# Autodesk Inventor assembly: decoder
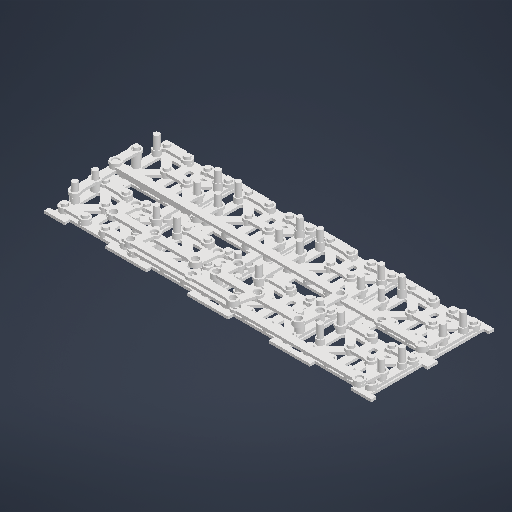
[picture p0: Inventor's stored thumbnail of the model, 512x512]
Saved by Autodesk Inventor 2025.4 (Build 294407000, 407)
## iProperties
Created: 2026-09-15
Part Number: decoder
Document SubType Name: Assembly
Designer: User
Author: User
## Documents named in this file (18)
- G:\projects\primary\mechanical-computer\mechanics\gates\decoder.iam
- G:\projects\primary\mechanical-computer\mechanics\lock\lock.iam
- G:\projects\primary\mechanical-computer\mechanics\links\link.ipt
- G:\projects\primary\mechanical-computer\mechanics\links\link\link-8.ipt
- G:\projects\primary\mechanical-computer\mechanics\links\link-1-turn-rigid\link-1-turn-rigid-8(_AS)4w-8l.ipt
- G:\projects\primary\mechanical-computer\mechanics\links\link-1-turn-rigid.ipt
- G:\projects\primary\mechanical-computer\mechanics\links\link\link-16.ipt
- G:\projects\primary\mechanical-computer\mechanics\links\link-split\link-split-16ab.ipt
- G:\projects\primary\mechanical-computer\mechanics\links\link-split.ipt
- G:\projects\primary\mechanical-computer\mechanics\links\link-split\link-split-8(_AS)5a-8(_AS)6b.ipt
- G:\projects\primary\mechanical-computer\mechanics\links\leveller.ipt
- G:\projects\primary\mechanical-computer\mechanics\links\leveller\leveller-2.ipt
- G:\projects\primary\mechanical-computer\mechanics\links\link-split\link-split-8(_AS)2ab.ipt
- G:\projects\primary\mechanical-computer\mechanics\links\link-split\link-split-8(_AS)3a-8(_AS)2b.ipt
- G:\projects\primary\mechanical-computer\mechanics\links\link\link-8-1pin.ipt
- G:\projects\primary\mechanical-computer\mechanics\links\link-1-turn-rigid\link-1-turn-rigid-11(_AS)8w-8l.ipt
- G:\projects\primary\mechanical-computer\mechanics\links\leveller\leveller-3.ipt
- G:\projects\primary\mechanical-computer\mechanics\links\leveller\leveller-1.ipt
## Components (40 placed, 14 different names)
1. link-1-turn-rigid-8(_AS)4w-8l:1 — Cylindrical:9, Cylindrical:10, Cylindrical:52, Mate:50
2. link-split-16ab:1 — Mate:20, Cylindrical:48, Cylindrical:50
3. link-1-turn-rigid-11(_AS)8w-8l:2 — Cylindrical:29, Cylindrical:30, Mate:49, Cylindrical:62
4. link-split-8(_AS)5a-8(_AS)6b:3 — Mate:25, Cylindrical:46, Cylindrical:47
5. leveller-1:6 — Mate:52, Cylindrical:58
6. leveller-1:7 — Mate:53, Cylindrical:59
7. leveller-1:8 — Mate:54, Cylindrical:60
8. leveller-1:9 — Mate:55, Cylindrical:61
9. lock:1 [sub-assembly] — Mate:1, Flush:1, Flush:2, Mate:3, Flush:5, Flush:6, Cylindrical:9, Cylindrical:10, Cylindrical:13, Mate:14, Mate:27, Mate:28, Mate:29, Mate:30, Cylindrical:53
10. lock:2 [sub-assembly] — Mate:1, Flush:1, Flush:2, Mate:7, Flush:13, Flush:14, Cylindrical:15, Mate:15, Cylindrical:32, Mate:26, Cylindrical:54
11. lock:3 [sub-assembly] — Mate:3, Flush:5, Flush:6, Cylindrical:14, Mate:36, Mate:37, Mate:55, Cylindrical:61, Cylindrical:63
12. lock:4 [sub-assembly] — Cylindrical:12, Mate:13, Cylindrical:16, Mate:54, Cylindrical:60
13. lock:5 [sub-assembly] — Mate:7, Flush:13, Flush:14, Cylindrical:17, Mate:16, Cylindrical:29, Cylindrical:30, Mate:32, Mate:33, Mate:34, Mate:35, Cylindrical:55
14. lock:6 [sub-assembly] — Cylindrical:19, Mate:17, Cylindrical:33, Mate:24, Cylindrical:56
15. lock:7 [sub-assembly] — Cylindrical:18, Mate:18, Cylindrical:51, Mate:53, Cylindrical:59
16. lock:8 [sub-assembly] — Cylindrical:20, Mate:19, Cylindrical:49, Mate:52, Cylindrical:58
17. leveller:1 — Mate:27, Mate:28
18. leveller:2 — Mate:29, Mate:30, Mate:50
19. leveller-2:3 — Mate:32, Mate:33
20. leveller-2:4 — Mate:34, Mate:35, Mate:49
21. leveller-3:5 — Mate:36, Mate:37, Mate:56
22. link-8-1pin:5 — Cylindrical:12, Mate:13, Cylindrical:52
23. link-8-1pin:12 — Mate:18, Cylindrical:50, Cylindrical:51
24. link-8-1pin:13 — Mate:19, Mate:20, Cylindrical:48, Cylindrical:49
25. link-8-1pin:14 — Mate:56, Cylindrical:62, Cylindrical:63
26. link-8-1pin:15 — Cylindrical:32, Mate:26, Cylindrical:47
27. link-8-1pin:16 — Cylindrical:33, Mate:24, Mate:25, Cylindrical:46
28. link-16:6 — Cylindrical:13, Cylindrical:14, Mate:14
29. link-16:7 — Cylindrical:15, Cylindrical:16, Mate:15
30. link-16:8 — Cylindrical:17, Cylindrical:18, Mate:16
31. link-16:9 — Cylindrical:19, Cylindrical:20, Mate:17
32. link-split-8(_AS)2ab:4 — Cylindrical:36, Cylindrical:38, Mate:38, Mate:39, Cylindrical:41, Mate:46
33. link-split-8(_AS)2ab:5 — Cylindrical:37, Cylindrical:39, Mate:40, Mate:41, Cylindrical:40, Mate:47
34. link-split-8(_AS)3a-8(_AS)2b:6 — Cylindrical:42, Cylindrical:43, Mate:44, Mate:45
35. link-8:21 — Cylindrical:41, Cylindrical:42, Mate:44, Mate:46
36. link-8:22 — Cylindrical:40, Cylindrical:43, Mate:45, Mate:47
37. link-8:18 — Cylindrical:36, Mate:39, Cylindrical:54
38. link-8:17 — Cylindrical:38, Mate:38, Cylindrical:53
39. link-8:19 — Cylindrical:39, Mate:40, Cylindrical:55
40. link-8:20 — Cylindrical:37, Mate:41, Cylindrical:56
## Relationships (97: Mate 43, CylindricalJoint 40, Flush 14)
- Mate:1: lock:1 ↔ lock:2
- Flush:1: lock:1 ↔ lock:2
- Flush:2: lock:1 ↔ lock:2
- [Mate]: lock:3 ↔ lock:4
- [Flush]: lock:3 ↔ lock:4
- [Flush]: lock:3 ↔ lock:4
- Mate:3: lock:1 ↔ lock:3
- Flush:5: lock:1 ↔ lock:3
- Flush:6: lock:1 ↔ lock:3
- [Mate]: lock:5 ↔ lock:6
- [Flush]: lock:5 ↔ lock:6
- [Flush]: lock:5 ↔ lock:6
- [Mate]: lock:7 ↔ lock:8
- [Flush]: lock:7 ↔ lock:8
- [Flush]: lock:7 ↔ lock:8
- [Mate]: lock:5 ↔ lock:7
- [Flush]: lock:5 ↔ lock:7
- [Flush]: lock:5 ↔ lock:7
- Mate:7: lock:2 ↔ lock:5
- Flush:13: lock:2 ↔ lock:5
- Flush:14: lock:2 ↔ lock:5
- Cylindrical:9: link-1-turn-rigid-8(_AS)4w-8l:1 ↔ lock:1
- Cylindrical:10: link-1-turn-rigid-8(_AS)4w-8l:1 ↔ lock:1
- Cylindrical:12: lock:4 ↔ link-8-1pin:5
- Mate:13: lock:4 ↔ link-8-1pin:5
- Cylindrical:13: lock:1 ↔ link-16:6
- Cylindrical:14: lock:3 ↔ link-16:6
- Cylindrical:15: lock:2 ↔ link-16:7
- Cylindrical:16: lock:4 ↔ link-16:7
- Cylindrical:17: lock:5 ↔ link-16:8
- Cylindrical:18: lock:7 ↔ link-16:8
- Cylindrical:19: lock:6 ↔ link-16:9
- Cylindrical:20: lock:8 ↔ link-16:9
- Mate:14: lock:1 ↔ link-16:6
- Mate:15: lock:2 ↔ link-16:7
- Mate:16: lock:5 ↔ link-16:8
- Mate:17: lock:6 ↔ link-16:9
- Mate:18: lock:7 ↔ link-8-1pin:12
- Mate:19: lock:8 ↔ link-8-1pin:13
- Mate:20: link-split-16ab:1 ↔ link-8-1pin:13
- Cylindrical:29: link-1-turn-rigid-11(_AS)8w-8l:2 ↔ lock:5
- Cylindrical:30: link-1-turn-rigid-11(_AS)8w-8l:2 ↔ lock:5
- Cylindrical:32: lock:2 ↔ link-8-1pin:15
- Cylindrical:33: lock:6 ↔ link-8-1pin:16
- Mate:24: lock:6 ↔ link-8-1pin:16
- Mate:25: link-split-8(_AS)5a-8(_AS)6b:3 ↔ link-8-1pin:16
- Mate:26: lock:2 ↔ link-8-1pin:15
- Mate:27: lock:1 ↔ leveller:1
- Mate:28: lock:1 ↔ leveller:1
- Mate:29: lock:1 ↔ leveller:2
- Mate:30: lock:1 ↔ leveller:2
- Mate:32: lock:5 ↔ leveller-2:3
- Mate:33: lock:5 ↔ leveller-2:3
- Mate:34: lock:5 ↔ leveller-2:4
- Mate:35: lock:5 ↔ leveller-2:4
- Mate:36: lock:3 ↔ leveller-3:5
- Mate:37: lock:3 ↔ leveller-3:5
- Cylindrical:36: link-split-8(_AS)2ab:4 ↔ link-8:18
- Cylindrical:37: link-split-8(_AS)2ab:5 ↔ link-8:20
- Cylindrical:38: link-split-8(_AS)2ab:4 ↔ link-8:17
- Cylindrical:39: link-split-8(_AS)2ab:5 ↔ link-8:19
- Mate:38: link-split-8(_AS)2ab:4 ↔ link-8:17
- Mate:39: link-split-8(_AS)2ab:4 ↔ link-8:18
- Mate:40: link-split-8(_AS)2ab:5 ↔ link-8:19
- Mate:41: link-split-8(_AS)2ab:5 ↔ link-8:20
- Cylindrical:40: link-split-8(_AS)2ab:5 ↔ link-8:22
- Cylindrical:41: link-split-8(_AS)2ab:4 ↔ link-8:21
- Cylindrical:42: link-split-8(_AS)3a-8(_AS)2b:6 ↔ link-8:21
- Cylindrical:43: link-split-8(_AS)3a-8(_AS)2b:6 ↔ link-8:22
- Mate:44: link-split-8(_AS)3a-8(_AS)2b:6 ↔ link-8:21
- Mate:45: link-split-8(_AS)3a-8(_AS)2b:6 ↔ link-8:22
- Cylindrical:46: link-split-8(_AS)5a-8(_AS)6b:3 ↔ link-8-1pin:16
- Cylindrical:47: link-split-8(_AS)5a-8(_AS)6b:3 ↔ link-8-1pin:15
- Cylindrical:48: link-split-16ab:1 ↔ link-8-1pin:13
- Cylindrical:49: lock:8 ↔ link-8-1pin:13
- Cylindrical:50: link-split-16ab:1 ↔ link-8-1pin:12
- Cylindrical:51: lock:7 ↔ link-8-1pin:12
- Cylindrical:52: link-1-turn-rigid-8(_AS)4w-8l:1 ↔ link-8-1pin:5
- Mate:46: link-split-8(_AS)2ab:4 ↔ link-8:21
- Mate:47: link-split-8(_AS)2ab:5 ↔ link-8:22
- Cylindrical:53: lock:1 ↔ link-8:17
- Cylindrical:54: lock:2 ↔ link-8:18
- Cylindrical:55: lock:5 ↔ link-8:19
- Cylindrical:56: lock:6 ↔ link-8:20
- Mate:49: link-1-turn-rigid-11(_AS)8w-8l:2 ↔ leveller-2:4
- Mate:50: link-1-turn-rigid-8(_AS)4w-8l:1 ↔ leveller:2
- Mate:52: leveller-1:6 ↔ lock:8
- Mate:53: leveller-1:7 ↔ lock:7
- Mate:54: leveller-1:8 ↔ lock:4
- Mate:55: leveller-1:9 ↔ lock:3
- Cylindrical:58: leveller-1:6 ↔ lock:8
- Cylindrical:59: leveller-1:7 ↔ lock:7
- Cylindrical:60: leveller-1:8 ↔ lock:4
- Cylindrical:61: leveller-1:9 ↔ lock:3
- Mate:56: leveller-3:5 ↔ link-8-1pin:14
- Cylindrical:62: link-1-turn-rigid-11(_AS)8w-8l:2 ↔ link-8-1pin:14
- Cylindrical:63: lock:3 ↔ link-8-1pin:14
## Named parameters: d34_d31 = 0 mm, d35_d32 = 0 mm, d36_d33 = 0 mm, d46_d43 = 0 mm, d47_d44 = 0 mm, d48_d45 = 0 mm, d49_d31 = 0 mm, d50_d32 = 0 mm, d51_d33 = 0 mm, d52_d34_d31 = 0 mm, d53_d35_d32 = 0 mm, d54_d36_d33 = 0 mm
